# Autodesk Inventor assembly: ensamblaje case
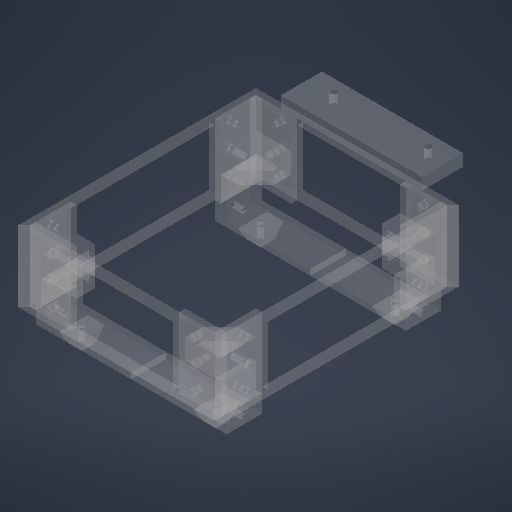
[picture p0: Inventor's stored thumbnail of the model, 512x512]
Saved by Autodesk Inventor 2027.2 (Build 312334000, 334)
## iProperties
Created: 2026-11-12
Part Number: ensamblaje case
Document SubType Name: Assembly
Designer: Jaime
Author: Jaime
## Documents named in this file (7)
- C:\Users\Jaime\AppData\Roaming\Microsoft\Windows\Network Shortcuts\UTP\Robot B2\case\ensamblaje case v1.iam
- C:\Users\Jaime\AppData\Roaming\Microsoft\Windows\Network Shortcuts\UTP\Robot B2\case\ensamblaje case.ipt
- C:\Users\Jaime\AppData\Roaming\Microsoft\Windows\Network Shortcuts\UTP\Robot B2\case\lateral corto abajo.ipt
- C:\Users\Jaime\AppData\Roaming\Microsoft\Windows\Network Shortcuts\UTP\Robot B2\case\lateral largo.ipt
- C:\Users\Jaime\AppData\Roaming\Microsoft\Windows\Network Shortcuts\UTP\Robot B2\case\lateral corto.ipt
- C:\Users\Jaime\AppData\Roaming\Microsoft\Windows\Network Shortcuts\UTP\Robot B2\case\esquineras del radar.ipt
- C:\Users\Jaime\AppData\Roaming\Microsoft\Windows\Network Shortcuts\UTP\Robot B2\case\tapa frontal.ipt
## Components (11 placed, 6 different names)
1. ensamblaje case:1
2. lateral corto abajo:1 — Rígido:1, Rígido:2
3. lateral largo:1 — Rígido:1, Rígido:3, Rígido:4, Rígido:5
4. lateral largo:2 — Rígido:2, Rígido:6, Rígido:7
5. lateral corto:1 — Rígido:3
6. esquineras del radar:1 — Rígido:4
7. esquineras del radar:2 — Rígido:5, Rígido:9
8. esquineras del radar:3 — Rígido:6
9. esquineras del radar:4 — Rígido:7, Rígido:8
10. tapa frontal:1 — Rígido:8
11. tapa frontal:2 — Rígido:9
## Relationships (9: WeldJoint 9)
- Rígido:1 [WeldJoint]: lateral corto abajo:1 ↔ lateral largo:1
- Rígido:2 [WeldJoint]: lateral corto abajo:1 ↔ lateral largo:2
- Rígido:3 [WeldJoint]: lateral largo:1 ↔ lateral corto:1
- Rígido:4 [WeldJoint]: lateral largo:1 ↔ esquineras del radar:1
- Rígido:5 [WeldJoint]: lateral largo:1 ↔ esquineras del radar:2
- Rígido:6 [WeldJoint]: lateral largo:2 ↔ esquineras del radar:3
- Rígido:7 [WeldJoint]: lateral largo:2 ↔ esquineras del radar:4
- Rígido:8 [WeldJoint]: esquineras del radar:4 ↔ tapa frontal:1
- Rígido:9 [WeldJoint]: esquineras del radar:2 ↔ tapa frontal:2
